# Autodesk Inventor assembly: Tarot
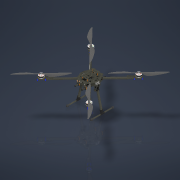
[picture p0: Inventor's stored thumbnail of the model, 180x180]
Saved by Autodesk Inventor 2021 (Build 250183000, 183)
## iProperties
Created: 2021-05-30
Part Number: Tarot
Document SubType Name: Assembly
Designer: Galih Sukma Adjie
landingG1: 180.00 deg
landingG2: 0.00 deg
arm1: 180.00 deg
arm2: 0.00 deg
arm3: 180.00 deg
arm4: 0.00 deg
motor1: 135.00 deg
motor2: -45.00 deg
motor3: -45.00 deg
motor4: 135.00 deg
Author: Galih Sukma Adjie
## Documents named in this file (18)
- D:\Experimen\Inventor\BAYUCARAKA\Tarot\Tarot.iam
- D:\Experimen\Inventor\BAYUCARAKA\Tarot\Lower Base.ipt
- D:\Experimen\Inventor\BAYUCARAKA\Tarot\spacer 22mm silver.ipt
- D:\Experimen\Inventor\BAYUCARAKA\Tarot\Arm Clip\20021-003_arm-clip.iam
- D:\Experimen\Inventor\BAYUCARAKA\Tarot\ArmAssembly\ArmAssembly1.iam
- D:\Experimen\Inventor\BAYUCARAKA\Tarot\side bracket bottom.ipt
- D:\Experimen\Inventor\BAYUCARAKA\Tarot\bracket landing gear.ipt
- D:\Experimen\Inventor\BAYUCARAKA\Tarot\Upper Base.ipt
- D:\Experimen\Inventor\BAYUCARAKA\Tarot\Landing Gear bawah\Landing Gear bawah.iam
- D:\Experimen\Inventor\BAYUCARAKA\Tarot\side bracket top.ipt
- D:\Experimen\Inventor\BAYUCARAKA\Tarot\lower support.ipt
- D:\Experimen\Inventor\BAYUCARAKA\Tarot\Lower Tube.ipt
- D:\Experimen\Inventor\BAYUCARAKA\Tarot\payload rod cap.ipt
- D:\Experimen\Inventor\BAYUCARAKA\Tarot\spacer 22mm orange.ipt
- D:\Experimen\Inventor\BAYUCARAKA\Tarot\top base.ipt
- D:\Experimen\Inventor\BAYUCARAKA\Tarot\MN 3508\15x5 v1.ipt
- D:\Experimen\Inventor\BAYUCARAKA\Tarot\spacer landing gear 22mm.ipt
- D:\Experimen\Inventor\BAYUCARAKA\Tarot\MN 3508\bell.ipt
## Components (59 placed, 17 different names)
1. Lower Base:1 — Mate:1, Mate:2, Mate:3, Mate:4, Mate:5, Mate:6, Mate:7, Mate:8, Mate:9, Mate:10, Mate:11, Mate:12, Mate:13, Mate:14, Mate:15, Mate:16, Mate:17, Mate:18, Mate:19, Mate:20, Mate:21, Mate:22, Mate:23, Mate:24, Mate:25, Mate:26, Mate:27, Mate:28, Mate:29, Mate:30, Mate:31, Mate:32, Mate:33, Mate:34, Flush:1, Mate:35, Mate:36, Mate:37, Mate:38, Mate:39, Mate:40, Mate:41, Mate:42, Mate:43, Mate:44, Mate:45, Mate:46, Mate:47, Mate:48, Mate:49, Mate:50, Mate:53, Mate:56, Mate:57, Mate:83, Mate:84, Mate:85, Mate:86, Mate:87, Mate:88, Mate:89, Mate:90, Mate:91, Mate:92, Mate:93, Mate:94
2. spacer 22mm silver:1 — Mate:1, Mate:16, Mate:65
3. spacer 22mm silver:2 — Mate:3, Mate:11
4. spacer 22mm silver:3 — Mate:2, Mate:10
5. spacer 22mm silver:4 — Mate:4, Mate:13, Mate:64
6. spacer 22mm silver:5 — Mate:5, Mate:12, Mate:62, Mate:63
7. spacer 22mm silver:6 — Mate:6, Mate:9
8. spacer 22mm silver:7 — Mate:7, Mate:8
9. spacer 22mm silver:8 — Mate:14, Mate:15, Mate:66
10. spacer 22mm silver:9 — Mate:19, Mate:23
11. spacer 22mm silver:10 — Mate:20, Mate:24
12. spacer 22mm silver:11 — Mate:18, Mate:22
13. spacer 22mm silver:12 — Mate:17, Mate:21
14. 20021-003_arm-clip:1 [sub-assembly] — Mate:25, Mate:26, Mate:27, Angle:3
15. 20021-003_arm-clip:2 [sub-assembly] — Mate:28, Mate:29, Mate:30, Angle:4
16. 20021-003_arm-clip:3 [sub-assembly] — Mate:31, Mate:32, Mate:33, Angle:1
17. 20021-003_arm-clip:4 [sub-assembly] — Mate:34, Flush:1, Mate:35, Angle:2
18. ArmAssembly1:1 [sub-assembly] — Mate:42, Mate:43, Angle:3, Mate:120, Mate:128, Mate:133, Angle:7
19. ArmAssembly1:2 [sub-assembly] — Mate:40, Mate:41, Angle:4, Mate:117, Mate:129, Mate:134, Angle:8
20. ArmAssembly1:3 [sub-assembly] — Mate:36, Mate:37, Angle:2, Mate:119, Mate:127, Mate:132, Angle:9
21. ArmAssembly1:4 [sub-assembly] — Mate:38, Mate:39, Angle:1, Mate:121, Mate:130, Mate:131, Angle:10
22. side bracket bottom:1 — Mate:44, Mate:45, Mate:46, Mate:58, Mate:59, Mate:60, Mate:61, Mate:82
23. side bracket bottom:2 — Mate:47, Mate:48, Mate:49, Mate:51, Mate:52, Mate:54, Mate:55
24. bracket landing gear:1 — Mate:50, Mate:51, Mate:52, Mate:75, Mate:76, Mate:123
25. bracket landing gear:2 — Mate:53, Mate:54, Mate:55, Mate:67, Mate:68, Mate:69, Mate:124
26. bracket landing gear:3 — Mate:56, Mate:60, Mate:61, Mate:71, Mate:72, Mate:73, Mate:74, Mate:125
27. bracket landing gear:4 — Mate:57, Mate:58, Mate:59, Mate:70, Mate:122
28. Upper Base:1 — Mate:62, Mate:63, Mate:64, Mate:65, Mate:66, Mate:77, Mate:78, Mate:79, Mate:80, Mate:81, Mate:105, Mate:106, Mate:107, Mate:108, Mate:109, Mate:110, Mate:111, Mate:112
29. 20021-003_arm-clip:5 [sub-assembly] — Mate:70, Mate:71, Mate:72, Angle:6
30. 20021-003_arm-clip:6 [sub-assembly] — Mate:67, Mate:68, Mate:69, Angle:5
31. Landing Gear bawah:1 [sub-assembly] — Mate:73, Mate:74, Angle:6
32. Landing Gear bawah:2 [sub-assembly] — Mate:75, Mate:76, Angle:5
33. side bracket top:1 — Mate:80, Mate:81, Mate:82
34. side bracket top:2 — Mate:77, Mate:78, Mate:79
35. lower support:1 — Mate:83, Mate:84, Mate:85, Mate:96
36. lower support:2 — Mate:86, Mate:87, Mate:88, Mate:95
37. lower support:3 — Mate:90, Mate:91, Mate:92, Flush:2
38. lower support:4 — Mate:89, Mate:93, Mate:94, Flush:3
39. Lower Tube:1 — Mate:96, Flush:3, Mate:98, Mate:100, Mate:103, Mate:104
40. Lower Tube:2 — Mate:95, Flush:2, Mate:97, Mate:99, Mate:101, Mate:102
41. payload rod cap:1 — Mate:97, Mate:99
42. payload rod cap:2 — Mate:98, Mate:100
43. payload rod cap:3 — Mate:101, Mate:102
44. payload rod cap:4 — Mate:103, Mate:104
45. spacer 22mm orange:1 — Mate:105, Mate:106
46. spacer 22mm orange:2 — Mate:107, Mate:108
47. spacer 22mm orange:3 — Mate:109, Mate:110, Mate:115
48. spacer 22mm orange:4 — Mate:111, Mate:112, Mate:113, Mate:114
49. top base:1 — Mate:113, Mate:114, Mate:115
50. 15x5 v1:1 — Mate:117, Mate:138, Mate:139
51. 15x5 v1:2 — Mate:119, Mate:136, Mate:141
52. 15x5 v1:3 — Mate:121, Mate:137, Mate:140
53. 15x5 v1:4 — Mate:120, Mate:135, Mate:142
54. spacer landing gear 22mm:1 — Mate:123, Mate:124
55. spacer landing gear 22mm:2 — Mate:122, Mate:125
56. bell:1 — Mate:128, Mate:133, Angle:7, Mate:135, Mate:142
57. bell:2 — Mate:127, Mate:132, Angle:9, Mate:136, Mate:141
58. bell:3 — Mate:130, Mate:131, Angle:10, Mate:137, Mate:140
59. bell:4 — Mate:129, Mate:134, Angle:8, Mate:138, Mate:139
## Relationships (152: Mate 139, Angle 10, Flush 3)
- Mate:1: Lower Base:1 ↔ spacer 22mm silver:1
- Mate:2: Lower Base:1 ↔ spacer 22mm silver:3
- Mate:3: Lower Base:1 ↔ spacer 22mm silver:2
- Mate:4: Lower Base:1 ↔ spacer 22mm silver:4
- Mate:5: Lower Base:1 ↔ spacer 22mm silver:5
- Mate:6: Lower Base:1 ↔ spacer 22mm silver:6
- Mate:7: Lower Base:1 ↔ spacer 22mm silver:7
- Mate:8: Lower Base:1 ↔ spacer 22mm silver:7
- Mate:9: Lower Base:1 ↔ spacer 22mm silver:6
- Mate:10: Lower Base:1 ↔ spacer 22mm silver:3
- Mate:11: Lower Base:1 ↔ spacer 22mm silver:2
- Mate:12: Lower Base:1 ↔ spacer 22mm silver:5
- Mate:13: Lower Base:1 ↔ spacer 22mm silver:4
- Mate:14: Lower Base:1 ↔ spacer 22mm silver:8
- Mate:15: Lower Base:1 ↔ spacer 22mm silver:8
- Mate:16: Lower Base:1 ↔ spacer 22mm silver:1
- Mate:17: Lower Base:1 ↔ spacer 22mm silver:12
- Mate:18: Lower Base:1 ↔ spacer 22mm silver:11
- Mate:19: Lower Base:1 ↔ spacer 22mm silver:9
- Mate:20: Lower Base:1 ↔ spacer 22mm silver:10
- Mate:21: Lower Base:1 ↔ spacer 22mm silver:12
- Mate:22: Lower Base:1 ↔ spacer 22mm silver:11
- Mate:23: Lower Base:1 ↔ spacer 22mm silver:9
- Mate:24: Lower Base:1 ↔ spacer 22mm silver:10
- Mate:25: Lower Base:1 ↔ 20021-003_arm-clip:1
- Mate:26: Lower Base:1 ↔ 20021-003_arm-clip:1
- Mate:27: Lower Base:1 ↔ 20021-003_arm-clip:1
- Mate:28: Lower Base:1 ↔ 20021-003_arm-clip:2
- Mate:29: Lower Base:1 ↔ 20021-003_arm-clip:2
- Mate:30: Lower Base:1 ↔ 20021-003_arm-clip:2
- Mate:31: Lower Base:1 ↔ 20021-003_arm-clip:3
- Mate:32: Lower Base:1 ↔ 20021-003_arm-clip:3
- Mate:33: Lower Base:1 ↔ 20021-003_arm-clip:3
- Mate:34: Lower Base:1 ↔ 20021-003_arm-clip:4
- Flush:1: Lower Base:1 ↔ 20021-003_arm-clip:4
- Mate:35: Lower Base:1 ↔ 20021-003_arm-clip:4
- Mate:36: Lower Base:1 ↔ ArmAssembly1:3
- Mate:37: Lower Base:1 ↔ ArmAssembly1:3
- Mate:38: Lower Base:1 ↔ ArmAssembly1:4
- Mate:39: Lower Base:1 ↔ ArmAssembly1:4
- Mate:40: Lower Base:1 ↔ ArmAssembly1:2
- Mate:41: Lower Base:1 ↔ ArmAssembly1:2
- Mate:42: Lower Base:1 ↔ ArmAssembly1:1
- Mate:43: Lower Base:1 ↔ ArmAssembly1:1
- Mate:44: Lower Base:1 ↔ side bracket bottom:1
- Mate:45: Lower Base:1 ↔ side bracket bottom:1
- Mate:46: Lower Base:1 ↔ side bracket bottom:1
- Mate:47: Lower Base:1 ↔ side bracket bottom:2
- Mate:48: Lower Base:1 ↔ side bracket bottom:2
- Mate:49: Lower Base:1 ↔ side bracket bottom:2
- Mate:50: Lower Base:1 ↔ bracket landing gear:1
- Mate:51: side bracket bottom:2 ↔ bracket landing gear:1
- Mate:52: side bracket bottom:2 ↔ bracket landing gear:1
- Mate:53: Lower Base:1 ↔ bracket landing gear:2
- Mate:54: side bracket bottom:2 ↔ bracket landing gear:2
- Mate:55: side bracket bottom:2 ↔ bracket landing gear:2
- Mate:56: Lower Base:1 ↔ bracket landing gear:3
- Mate:57: Lower Base:1 ↔ bracket landing gear:4
- Mate:58: side bracket bottom:1 ↔ bracket landing gear:4
- Mate:59: side bracket bottom:1 ↔ bracket landing gear:4
- Mate:60: side bracket bottom:1 ↔ bracket landing gear:3
- Mate:61: side bracket bottom:1 ↔ bracket landing gear:3
- Mate:62: spacer 22mm silver:5 ↔ Upper Base:1
- Mate:63: spacer 22mm silver:5 ↔ Upper Base:1
- Mate:64: spacer 22mm silver:4 ↔ Upper Base:1
- Mate:65: spacer 22mm silver:1 ↔ Upper Base:1
- Mate:66: spacer 22mm silver:8 ↔ Upper Base:1
- Mate:67: bracket landing gear:2 ↔ 20021-003_arm-clip:6
- Mate:68: bracket landing gear:2 ↔ 20021-003_arm-clip:6
- Mate:69: bracket landing gear:2 ↔ 20021-003_arm-clip:6
- Mate:70: bracket landing gear:4 ↔ 20021-003_arm-clip:5
- Mate:71: bracket landing gear:3 ↔ 20021-003_arm-clip:5
- Mate:72: bracket landing gear:3 ↔ 20021-003_arm-clip:5
- Angle:1 (180 deg): 20021-003_arm-clip:3 ↔ ArmAssembly1:4
- Angle:2 (0 deg): 20021-003_arm-clip:4 ↔ ArmAssembly1:3
- Angle:3 (180 deg): 20021-003_arm-clip:1 ↔ ArmAssembly1:1
- Angle:4 (0 deg): 20021-003_arm-clip:2 ↔ ArmAssembly1:2
- Mate:73: bracket landing gear:3 ↔ Landing Gear bawah:1
- Mate:74: bracket landing gear:3 ↔ Landing Gear bawah:1
- Mate:75: bracket landing gear:1 ↔ Landing Gear bawah:2
- Mate:76: bracket landing gear:1 ↔ Landing Gear bawah:2
- Angle:5 (180 deg): 20021-003_arm-clip:6 ↔ Landing Gear bawah:2
- Angle:6 (0 deg): 20021-003_arm-clip:5 ↔ Landing Gear bawah:1
- Mate:77: Upper Base:1 ↔ side bracket top:2
- Mate:78: Upper Base:1 ↔ side bracket top:2
- Mate:79: Upper Base:1 ↔ side bracket top:2
- Mate:80: Upper Base:1 ↔ side bracket top:1
- Mate:81: Upper Base:1 ↔ side bracket top:1
- Mate:82: side bracket bottom:1 ↔ side bracket top:1
- Mate:83: Lower Base:1 ↔ lower support:1
- Mate:84: Lower Base:1 ↔ lower support:1
- Mate:85: Lower Base:1 ↔ lower support:1
- Mate:86: Lower Base:1 ↔ lower support:2
- Mate:87: Lower Base:1 ↔ lower support:2
- Mate:88: Lower Base:1 ↔ lower support:2
- Mate:89: Lower Base:1 ↔ lower support:4
- Mate:90: Lower Base:1 ↔ lower support:3
- Mate:91: Lower Base:1 ↔ lower support:3
- Mate:92: Lower Base:1 ↔ lower support:3
- Mate:93: Lower Base:1 ↔ lower support:4
- Mate:94: Lower Base:1 ↔ lower support:4
- Mate:95: lower support:2 ↔ Lower Tube:2
- Mate:96: lower support:1 ↔ Lower Tube:1
- Flush:2 (-23.15 mm): lower support:3 ↔ Lower Tube:2
- Flush:3 (-23.15 mm): lower support:4 ↔ Lower Tube:1
- Mate:97: Lower Tube:2 ↔ payload rod cap:1
- Mate:98: Lower Tube:1 ↔ payload rod cap:2
- Mate:99: Lower Tube:2 ↔ payload rod cap:1
- Mate:100: Lower Tube:1 ↔ payload rod cap:2
- Mate:101: Lower Tube:2 ↔ payload rod cap:3
- Mate:102: Lower Tube:2 ↔ payload rod cap:3
- Mate:103: Lower Tube:1 ↔ payload rod cap:4
- Mate:104: Lower Tube:1 ↔ payload rod cap:4
- Mate:105: Upper Base:1 ↔ spacer 22mm orange:1
- Mate:106: Upper Base:1 ↔ spacer 22mm orange:1
- Mate:107: Upper Base:1 ↔ spacer 22mm orange:2
- Mate:108: Upper Base:1 ↔ spacer 22mm orange:2
- Mate:109: Upper Base:1 ↔ spacer 22mm orange:3
- Mate:110: Upper Base:1 ↔ spacer 22mm orange:3
- Mate:111: Upper Base:1 ↔ spacer 22mm orange:4
- Mate:112: Upper Base:1 ↔ spacer 22mm orange:4
- Mate:113: spacer 22mm orange:4 ↔ top base:1
- Mate:114: spacer 22mm orange:4 ↔ top base:1
- Mate:115: spacer 22mm orange:3 ↔ top base:1
- Mate:117: ArmAssembly1:2 ↔ 15x5 v1:1
- Mate:119: ArmAssembly1:3 ↔ 15x5 v1:2
- Mate:120: ArmAssembly1:1 ↔ 15x5 v1:4
- Mate:121: ArmAssembly1:4 ↔ 15x5 v1:3
- Mate:122: bracket landing gear:4 ↔ spacer landing gear 22mm:2
- Mate:123: bracket landing gear:1 ↔ spacer landing gear 22mm:1
- Mate:124: bracket landing gear:2 ↔ spacer landing gear 22mm:1
- Mate:125: bracket landing gear:3 ↔ spacer landing gear 22mm:2
- Mate:127: ArmAssembly1:3 ↔ bell:2
- Mate:128: ArmAssembly1:1 ↔ bell:1
- Mate:129: ArmAssembly1:2 ↔ bell:4
- Mate:130: ArmAssembly1:4 ↔ bell:3
- Mate:131 (0.566 mm): ArmAssembly1:4 ↔ bell:3
- Mate:132 (0.566 mm): ArmAssembly1:3 ↔ bell:2
- Mate:133 (0.566 mm): ArmAssembly1:1 ↔ bell:1
- Mate:134 (0.566 mm): ArmAssembly1:2 ↔ bell:4
- Angle:7 (135 deg): ArmAssembly1:1 ↔ bell:1
- Angle:8 (-45 deg): ArmAssembly1:2 ↔ bell:4
- Angle:9 (-45 deg): ArmAssembly1:3 ↔ bell:2
- Angle:10 (135 deg): ArmAssembly1:4 ↔ bell:3
- Mate:135: 15x5 v1:4 ↔ bell:1
- Mate:136: 15x5 v1:2 ↔ bell:2
- Mate:137: 15x5 v1:3 ↔ bell:3
- Mate:138: 15x5 v1:1 ↔ bell:4
- Mate:139: 15x5 v1:1 ↔ bell:4
- Mate:140: 15x5 v1:3 ↔ bell:3
- Mate:141: 15x5 v1:2 ↔ bell:2
- Mate:142: 15x5 v1:4 ↔ bell:1
